# Autodesk Inventor assembly: pattern-rect2
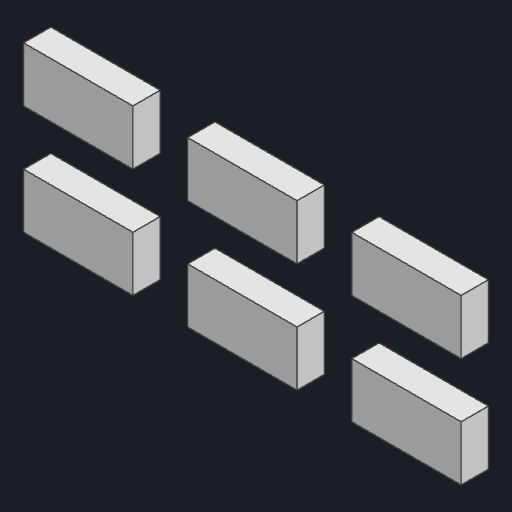
[picture p0: Inventor's stored thumbnail of the model, 512x512]
Saved by Autodesk Inventor 2026.1 (Build 301233000, 233)
## iProperties
Created: 2026-10-30
Part Number: pattern-rect2
Document SubType Name: Assembly
Designer: anony
Author: anony
## Documents named in this file (2)
- C:\Users\anony\OneDrive\Desktop\AI Projects\CAD Convert\corpus\generated\asm\pattern-rect2.iam
- C:\Users\anony\OneDrive\Desktop\AI Projects\CAD Convert\corpus\generated\asmparts\box.ipt
## Components (6 placed, 1 different names)
1. box:1
2. box:2
3. box:3
4. box:4
5. box:5
6. box:6
## Component patterns: (6 elements, first: box:1)
